# Autodesk Inventor assembly: MM0948AN002_G10_802
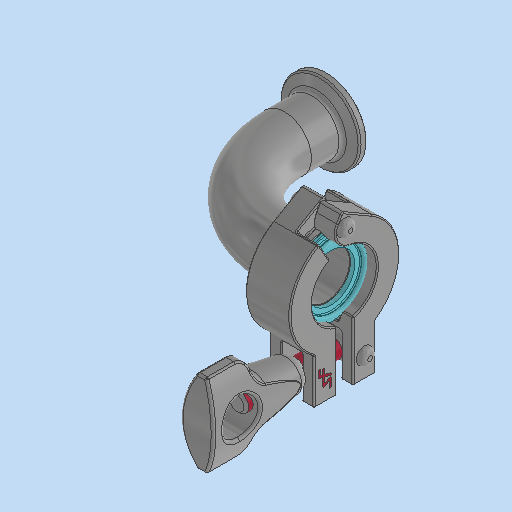
[picture p0: Inventor's stored thumbnail of the model, 512x512]
Saved by Autodesk Inventor 2023.3 (Build 273359000, 359)
## iProperties
RuleStatus: InUse
Created: 2023-02-14
Part Number: MM0948AN002_G10_802
Description: =<RBPARTNOTITLE2>
Document SubType Name: Assembly
Designer: krl4an
Mass: 252.474 g
Surface Area: 309.216 cm^2
Volume: 45.1837 cm^3
Density: 5.58773 g/cm^3
AnP_Material: =<Material>
AnP_TemplVers: 20200821
RBDOCUMENTTYPE: DRF
RBDOCUMENTVERSION: 00
RBDRAWINGMAINSCALE: 1:1
RBDRAWINGMISSINGSPEC: --
RBDRAWINGVOLUME: --
RBDSV1: 0850
RBGBEDGESIN1: +0,5
RBGBEDGESIN2: +0,2
RBGBEDGESOUT1: -0,3
RBGBEDGESOUT2: -0,1
RBMATERIAL: =<Material>
RBMATMEETS: --
RBMATNO: =<Part Number>
RBPARTMADEOF: --
RBPARTNO: SIEHE MNR
RBPARTNOTITLE1: --
RBPARTSAFETYINDICATOR: --
RBSURFACE: --
RBSURFACE2: --
RBZEDGESNORM: ISO13715:2002-06
RBZGENDIMCLASS: m
RBZGENDIMNORM: ISO 2768-1:1989-11
RBZGENGEOCLASS: H
RBZGENGEONORM: ISO 2768-2:1989-11
RBZSURFACENORM: ISO13D2:2002-02
RBZTOLERANCENORM: ISO 14405-1:2010-12
Author: krl4an
Keywords: =<RBPARTMADEOF>
Comments: =<RBSURFACE2>
Revision Number: 01
## Documents named in this file (4)
- C:\Users\rea9an\Documents\Inventor\TCAI2412_te1910_EM\AS00000928.iam
- C:\Users\rea9an\Documents\Inventor\TCAI2412_te1910_EM\PT00004360.ipt
- C:\Users\rea9an\Documents\Inventor\TCAI2412_te1910_EM\PT00004361.ipt
- C:\Users\rea9an\Documents\Inventor\TCAI2412_te1910_EM\PT00004364.ipt
## Components (3 placed, 3 different names)
1. PT00004364:1 — Passend:1, Passend:2, Fluchtend:4, Passend:3, Passend:4, Passend:5, Passend:6
2. PT00004360:1 — Passend:3, Passend:4
3. PT00004361:1 — Passend:5, Passend:6, Winkel:1
## Relationships (8: Mate 6, Flush 1, Angle 1)
- Passend:1 [Mate]: PT00004364:1
- Passend:2 [Mate]: PT00004364:1
- Fluchtend:4 [Flush]: PT00004364:1
- Passend:3 [Mate]: PT00004364:1 ↔ PT00004360:1
- Passend:4 [Mate]: PT00004364:1 ↔ PT00004360:1
- Passend:5 [Mate]: PT00004364:1 ↔ PT00004361:1
- Passend:6 [Mate]: PT00004364:1 ↔ PT00004361:1
- Winkel:1 [Angle] (90 deg): PT00004361:1
